# Autodesk Inventor assembly: Assembly3
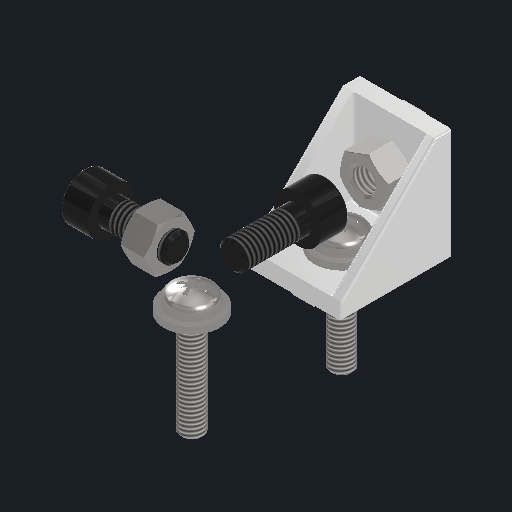
[picture p0: Inventor's stored thumbnail of the model, 512x512]
Saved by Autodesk Inventor 2027.1 (Build 311270010, 270A)
## iProperties
Created: 2026-11-17
Part Number: Assembly3
Document SubType Name: Assembly
Designer: SDS Scholar
Author: SDS Scholar
## Documents named in this file (6)
- E:\Apps\AutodeskInventor\University\MCT333_Design_of_Mechatronics_Systems_1\CAD\full_assembly\Assembly3.iam
- E:\Apps\AutodeskInventor\University\MCT333_Design_of_Mechatronics_Systems_1\CAD\off_the_shelf_components\CornerBracket2020\CornerBracket2020.ipt
- E:\Apps\AutodeskInventor\University\MCT333_Design_of_Mechatronics_Systems_1\CAD\fastners\bolts\m4\EN ISO 7045 - M4 x 20 - 4.8 - Z.ipt
- E:\Apps\AutodeskInventor\University\MCT333_Design_of_Mechatronics_Systems_1\CAD\fastners\bolts\m5\ISO 4762 - M5 x 12ISO.ipt
- E:\Apps\AutodeskInventor\University\MCT333_Design_of_Mechatronics_Systems_1\CAD\fastners\washers\ANSI B18.22M - 4 N.ipt
- E:\Apps\AutodeskInventor\University\MCT333_Design_of_Mechatronics_Systems_1\CAD\fastners\nuts\ANSI B 18.2.4.1 M - M5 x 0.8Style 1.ipt
## Components (9 placed, 5 different names)
1. CornerBracket2020:1
2. BS EN ISO 7045 Z - Metric M4 x 20 - 4.8 - Z:1
3. ISO 4762 M5 x 12:1
4. ISO 4762 M5 x 12:2
5. Plain Washer (Metric) 4 N:1
6. Hex Nut Metric M5 x 0.8:1
7. Hex Nut Metric M5 x 0.8:2
8. BS EN ISO 7045 Z - Metric M4 x 20 - 4.8 - Z:2
9. Plain Washer (Metric) 4 N:2
## Relationships (10: Mate 10)
- [Mate]: BS EN ISO 7045 Z - Metric M4 x 20 - 4.8 - Z:1 ↔ Plain Washer (Metric) 4 N:1
- [Mate]: BS EN ISO 7045 Z - Metric M4 x 20 - 4.8 - Z:1 ↔ Plain Washer (Metric) 4 N:1
- [Mate]: CornerBracket2020:1 ↔ BS EN ISO 7045 Z - Metric M4 x 20 - 4.8 - Z:1
- [Mate]: CornerBracket2020:1 ↔ Plain Washer (Metric) 4 N:1
- [Mate]: ISO 4762 M5 x 12:2 ↔ Hex Nut Metric M5 x 0.8:1
- [Mate]: CornerBracket2020:1 ↔ ISO 4762 M5 x 12:1
- [Mate]: CornerBracket2020:1 ↔ Hex Nut Metric M5 x 0.8:2
- [Mate]: ISO 4762 M5 x 12:1 ↔ Hex Nut Metric M5 x 0.8:2
- [Mate]: BS EN ISO 7045 Z - Metric M4 x 20 - 4.8 - Z:2 ↔ Plain Washer (Metric) 4 N:2
- [Mate]: BS EN ISO 7045 Z - Metric M4 x 20 - 4.8 - Z:2 ↔ Plain Washer (Metric) 4 N:2
